# Autodesk Inventor assembly: MN0542AN110_G03_003
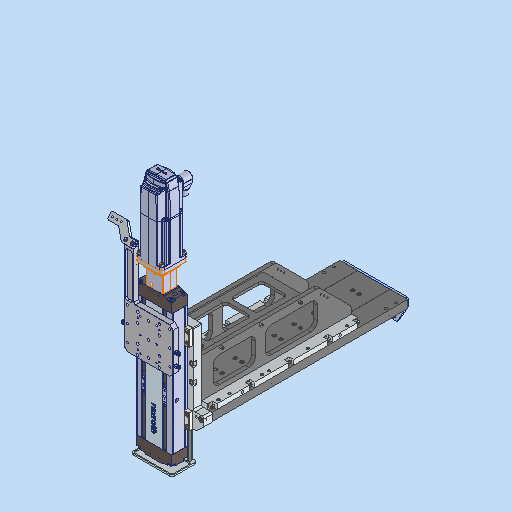
[picture p0: Inventor's stored thumbnail of the model, 512x512]
Saved by Autodesk Inventor 2023.3 (Build 273359000, 359)
## iProperties
RuleStatus: InUse
Created: 2021-01-21
Part Number: MN0542AN110_G03_003
Description: =<RBPARTNOTITLE2>
Document SubType Name: Assembly
Designer: ric7an
Mass: 8657.51 g
Surface Area: 18198.6 cm^2
Volume: 8657.51 cm^3
Density: 1 g/cm^3
AnP_Material: =<Material>
AnP_TemplVers: 20200821
RBDOCUMENTTYPE: DRF
RBDOCUMENTVERSION: 00
RBDRAWINGMAINSCALE: 1:1
RBDRAWINGMISSINGSPEC: --
RBDRAWINGVOLUME: --
RBDSV1: 0850
RBGBEDGESIN1: +0,5
RBGBEDGESIN2: +0,2
RBGBEDGESOUT1: -0,3
RBGBEDGESOUT2: -0,1
RBMATERIAL: =<Material>
RBMATMEETS: --
RBMATNO: =<Part Number>
RBPARTMADEOF: --
RBPARTNO: SIEHE MNR
RBPARTNOTITLE1: --
RBPARTSAFETYINDICATOR: --
RBSURFACE: --
RBSURFACE2: --
RBZEDGESNORM: ISO13715:2002-06
RBZGENDIMCLASS: m
RBZGENDIMNORM: ISO 2768-1:1989-11
RBZGENGEOCLASS: H
RBZGENGEONORM: ISO 2768-2:1989-11
RBZSURFACENORM: ISO13D2:2002-02
RBZTOLERANCENORM: ISO 14405-1:2010-12
Author: ric7an
Keywords: =<RBPARTMADEOF>
Comments: =<RBSURFACE2>
Revision Number: 01
## Documents named in this file (22)
- C:\Users\rea9an\Documents\Inventor\TCAI2412_te1910_EM\AS00000975.iam
- C:\Users\rea9an\Documents\Inventor\TCAI2412_te1910_EM\PT00004736.ipt
- C:\Users\rea9an\Documents\Inventor\TCAI2412_te1910_EM\PT00004752.ipt
- C:\Users\rea9an\Documents\Inventor\TCAI2412_te1910_EM\PT00004753.ipt
- C:\Users\rea9an\Documents\Inventor\TCAI2412_te1910_EM\PT00004738.ipt
- C:\Users\rea9an\Documents\Inventor\TCAI2412_te1910_EM\PT00004743.ipt
- C:\Users\rea9an\Documents\Inventor\TCAI2412_te1910_EM\PT00004744.ipt
- C:\Users\rea9an\Documents\Inventor\TCAI2412_te1910_EM\PT00004745.ipt
- C:\Users\rea9an\Documents\Inventor\TCAI2412_te1910_EM\PT00004747.ipt
- C:\Users\rea9an\Documents\Inventor\TCAI2412_te1910_EM\PT00004748.ipt
- C:\Users\rea9an\Documents\Inventor\TCAI2412_te1910_EM\PT00004749.ipt
- C:\Users\rea9an\Documents\Inventor\TCAI2412_te1910_EM\PT00004384.ipt
- C:\Users\rea9an\Documents\Inventor\TCAI2412_te1910_EM\PT00004386.ipt
- C:\Users\rea9an\Documents\Inventor\TCAI2412_te1910_EM\PT00004376.ipt
- C:\Users\rea9an\Documents\Inventor\TCAI2412_te1910_EM\PT00004377.ipt
- C:\Users\rea9an\Documents\Inventor\TCAI2412_te1910_EM\PT00004373.ipt
- C:\Users\rea9an\Documents\Inventor\TCAI2412_te1910_EM\PT00004381.ipt
- C:\Users\rea9an\Documents\Inventor\TCAI2412_te1910_EM\PT00004387.ipt
- C:\Users\rea9an\Documents\Inventor\TCAI2412_te1910_EM\PT00004378.ipt
- C:\Users\rea9an\Documents\Inventor\TCAI2412_te1910_EM\PT00004284.iam
- C:\Users\rea9an\Documents\Inventor\TCAI2412_te1910_EM\PT00004761.ipt
- C:\Users\rea9an\Documents\Inventor\TCAI2412_te1910_EM\AS00000976.iam
## Components (77 placed, 21 different names)
1. PT00004761:1 — Passend:1, Passend:2, Winkel:1
2. PT00004736:1
3. PT00004752:1
4. PT00004753:1 — Fluchtend:1, Passend:3, Passend:4
5. PT00004738:1
6. PT00004738:2
7. PT00004743:1
8. PT00004744:1
9. PT00004745:1
10. PT00004747:1
11. PT00004747:2
12. PT00004748:1
13. PT00004749:1
14. PT00004749:2
15. PT00004745:2
16. PT00004736:2
17. PT00004738:3
18. PT00004738:4
19. PT00004384:1
20. PT00004384:2
21. PT00004386:1
22. PT00004376:1
23. PT00004376:4
24. PT00004377:1
25. PT00004377:2
26. PT00004377:3
27. PT00004377:4
28. PT00004377:5
29. PT00004377:6
30. PT00004377:7
31. PT00004377:8
32. PT00004373:1
33. PT00004373:2
34. PT00004373:3
35. PT00004373:4
36. PT00004373:5
37. PT00004373:6
38. PT00004381:1
39. PT00004381:2
40. PT00004381:3
41. PT00004381:4
42. PT00004381:5
43. PT00004381:6
44. PT00004381:7
45. PT00004381:8
46. PT00004387:1
47. PT00004387:2
48. PT00004387:3
49. PT00004387:4
50. PT00004381:9
51. PT00004381:10
52. PT00004381:11
53. PT00004381:12
54. PT00004381:13
55. PT00004381:14
56. PT00004381:15
57. PT00004381:16
58. PT00004381:17
59. PT00004381:18
60. PT00004381:19
61. PT00004381:20
62. PT00004381:21
63. PT00004381:22
64. PT00004381:23
65. PT00004381:24
66. PT00004387:5
67. PT00004387:6
68. PT00004387:7
69. PT00004387:8
70. PT00004387:9
71. PT00004387:10
72. PT00004378:1
73. PT00004378:2
74. PT00004378:3
75. PT00004378:4
76. PT00004284:1 [sub-assembly] — Passend:1, Passend:2, Winkel:1
77. AS00000976:1 [sub-assembly] — Fluchtend:1, Passend:3, Passend:4
## Relationships (6: Mate 4, Angle 1, Flush 1)
- Passend:1 [Mate]: PT00004761:1 ↔ PT00004284:1
- Passend:2 [Mate]: PT00004761:1 ↔ PT00004284:1
- Winkel:1 [Angle] (180 deg): PT00004761:1 ↔ PT00004284:1
- Fluchtend:1 [Flush] (-20 mm): PT00004753:1 ↔ AS00000976:1
- Passend:3 [Mate] (1 mm): PT00004753:1 ↔ AS00000976:1
- Passend:4 [Mate] (27.5 mm): PT00004753:1 ↔ AS00000976:1
